# Autodesk Inventor assembly: 部件1
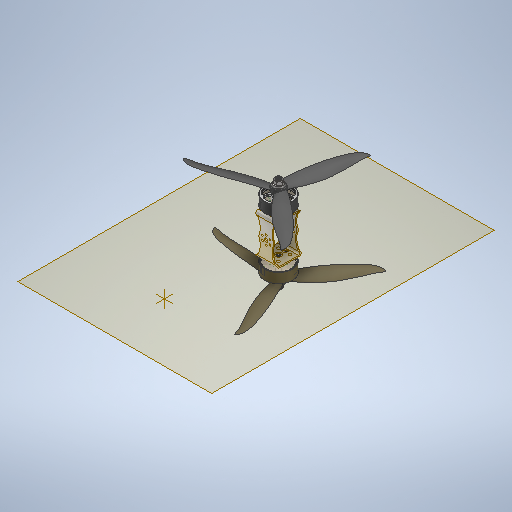
[picture p0: Inventor's stored thumbnail of the model, 512x512]
Saved by Autodesk Inventor 2025 (Build 290162000, 162)
## iProperties
Created: 2026-11-07
Part Number: 部件1
Document SubType Name: Assembly
Designer: ylh00
Mass: 155.715 g
Surface Area: 446.265 cm^2
Volume: 28.4917 cm^3
Density: 5.46526 g/cm^3
Author: ylh00
## Documents named in this file (5)
- D:\双轴共轴\部件1末端.iam
- D:\双轴共轴\支架.ipt
- D:\双轴共轴\电机.ipt
- D:\双轴共轴\桨叶.ipt
- C:\Users\ylh00\Documents\Inventor\Content Center Files\R2025\zh-CN\GB_T 6187.1-2000\螺母 GB_T 6187.1 M5.ipt
## Components (7 placed, 4 different names)
1. 支架:1 — 刚性:4, 刚性:5
2. 电机:1 — 旋转:4, 刚性:4
3. 电机:2 — 旋转:12, 刚性:5
4. 桨叶:1 — 旋转:4, 插入:1
5. 桨叶:2 — 旋转:12, 插入:2
6. 螺母 GB/T 6187.1-2000 M5:1 — 插入:1
7. 螺母 GB/T 6187.1-2000 M5:2 — 插入:2
## Relationships (6: RevoluteJoint 2, Insert 2, WeldJoint 2)
- 旋转:4 [RevoluteJoint]: 电机:1 ↔ 桨叶:1
- 插入:1 [Insert]: 桨叶:1 ↔ 螺母 GB/T 6187.1-2000 M5:1
- 旋转:12 [RevoluteJoint]: 电机:2 ↔ 桨叶:2
- 插入:2 [Insert]: 桨叶:2 ↔ 螺母 GB/T 6187.1-2000 M5:2
- 刚性:4 [WeldJoint]: 支架:1 ↔ 电机:1
- 刚性:5 [WeldJoint]: 支架:1 ↔ 电机:2
